# Autodesk Inventor assembly: Main
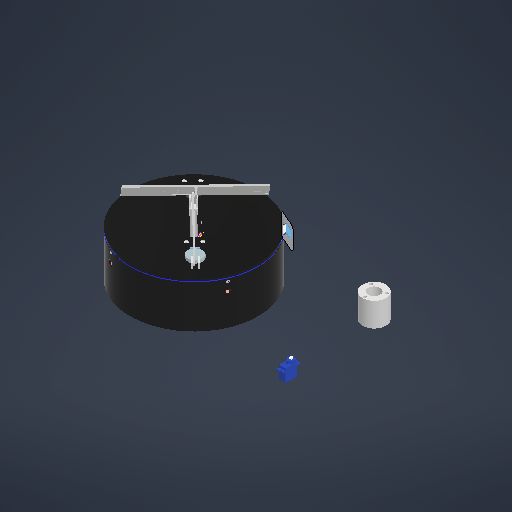
[picture p0: Inventor's stored thumbnail of the model, 512x512]
Saved by Autodesk Inventor 2027.1 (Build 311270010, 270A)
## iProperties
Created: 2026-11-02
Part Number: Main
Document SubType Name: Assembly
Designer: Rozkurwiator
Author: Rozkurwiator
## Documents named in this file (22)
- G:\Github\Suntracker\V2\Hardware\Main.iam
- G:\Github\Suntracker\V2\Hardware\Parts\base.ipt
- G:\Github\Suntracker\V2\Hardware\Parts\LDR\LDR.ipt
- G:\Github\Suntracker\V2\Hardware\Parts\Bearing_ball.ipt
- G:\Github\Suntracker\V2\Hardware\Parts\Cascet.ipt
- G:\Github\Suntracker\V2\Hardware\Parts\gwint_m3\gwint_m3.ipt
- G:\Github\Suntracker\V2\Hardware\Parts\srobka_m3\srobka_m3.ipt
- G:\Github\Suntracker\V2\Hardware\Parts\Slip Ring 12 Wire 22mm.ipt
- G:\Github\Suntracker\V2\Hardware\Parts\top.ipt
- G:\Github\Suntracker\V2\Hardware\Parts\Main_axis.ipt
- G:\Github\Suntracker\V2\Hardware\Parts\Stepper motor  1PC\Stepper motor  1PC.ipt
- G:\Github\Suntracker\V2\Hardware\Parts\9V Solar Cell 125mmx195mm v3\9V Solar Cell 125mmx195mm v3.ipt
- G:\Github\Suntracker\V2\Hardware\Parts\SERVO_SG90\SERVO_SG90.ipt
- G:\Github\Suntracker\V2\Hardware\Parts\sroba_toczna.ipt
- G:\Github\Suntracker\V2\Hardware\Parts\bearing_support.ipt
- G:\Github\Suntracker\V2\Hardware\Parts\10x15x4_bearing\10x15x4_bearing.ipt
- G:\Github\Suntracker\V2\Hardware\Parts\locomotive.ipt
- G:\Github\Suntracker\V2\Hardware\Parts\cuck_link.ipt
- G:\Github\Suntracker\V2\Hardware\Parts\panel_link.ipt
- G:\Github\Suntracker\V2\Hardware\Parts\Shaft_drive.ipt
- G:\Github\Suntracker\V2\Hardware\Parts\gearbox_parts\Przekładnie walcowe.iam
- G:\Github\Suntracker\V2\Hardware\Parts\azimuth_drive.ipt
## Components (105 placed, 21 different names)
1. base:1 — Zestawiające:1, Obrotowe:25, Obrotowe:27, Obrotowe:29, Obrotowe:33, Obrotowe:36
2. Cascet:1 — Obrotowe:29, Obrotowe:30
3. Slip Ring 12 Wire 22mm:1 — Obrotowe:31, Obrotowe:32
4. top:1 — Obrotowe:13, Obrotowe:14, Obrotowe:18, Obrotowe:23, Obrotowe:24, Obrotowe:31, Obrotowe:32, Obrotowe:36, Obrotowe:37
5. Stepper motor  1PC:1 — Obrotowe:21, Obrotowe:22
6. 9V Solar Cell 125mmx195mm v3:1 — Sztywne:1
7. SERVO_SG90:1
8. Main_axis:1
9. sroba_toczna:1 — Obrotowe:16, Walcowe:1, Obrót/przesunięcie:1
10. bearing_support:1 — Obrotowe:13, Obrotowe:14, Obrotowe:17
11. 10x15x4_bearing:1 — Obrotowe:16, Obrotowe:17
12. locomotive:1 — Walcowe:1, Obrotowe:19, Obrót/przesunięcie:1
13. cuck_link:1 — Obrotowe:18, Obrotowe:20
14. panel_link:1 — Obrotowe:19, Obrotowe:20, Sztywne:1
15. Shaft_drive:1 — Obrotowe:21, Obrotowe:22, Obrotowe:23, Obrotowe:24
16. Stepper motor  1PC:2 — Obrotowe:34, Obrotowe:35, Sztywne:2, Obrotowe:37
17. Przekładnie walcowe:1 [sub-assembly] — Obrotowe:33, Sztywne:2
18. azimuth_drive:1 — Obrotowe:34, Obrotowe:35
19. LDR:1 — Obrotowe:25
20. LDR:2
21. LDR:3
22. LDR:4
23. srobka_m3:1 — Obrotowe:5, Obrotowe:27
24. gwint_m3:1 — Obrotowe:5
25. srobka_m3:2
26. gwint_m3:2
27. srobka_m3:3
28. gwint_m3:3
29. srobka_m3:4
30. gwint_m3:4
31. Bearing_ball:1 — Obrotowe:30
32. Bearing_ball:2
33. Bearing_ball:3
34. Bearing_ball:4
35. Bearing_ball:5
36. Bearing_ball:6
37. Bearing_ball:7
38. Bearing_ball:8
39. Bearing_ball:9
40. Bearing_ball:10
41. Bearing_ball:11
42. Bearing_ball:12
43. Bearing_ball:13
44. Bearing_ball:14
45. Bearing_ball:15
46. Bearing_ball:16
47. Bearing_ball:17
48. Bearing_ball:18
49. Bearing_ball:19
50. Bearing_ball:20
51. Bearing_ball:21
52. Bearing_ball:22
53. Bearing_ball:23
54. Bearing_ball:24
55. Bearing_ball:25
56. Bearing_ball:26
57. Bearing_ball:27
58. Bearing_ball:28
59. Bearing_ball:29
60. Bearing_ball:30
61. Bearing_ball:31
62. Bearing_ball:32
63. Bearing_ball:33
64. Bearing_ball:34
65. Bearing_ball:35
66. Bearing_ball:36
67. Bearing_ball:37
68. Bearing_ball:38
69. Bearing_ball:39
70. Bearing_ball:40
71. Bearing_ball:41
72. Bearing_ball:42
73. Bearing_ball:43
74. Bearing_ball:44
75. Bearing_ball:45
76. Bearing_ball:46
77. Bearing_ball:47
78. Bearing_ball:48
79. Bearing_ball:49
80. Bearing_ball:50
81. Bearing_ball:51
82. Bearing_ball:52
83. Bearing_ball:53
84. Bearing_ball:54
85. Bearing_ball:55
86. Bearing_ball:56
87. Bearing_ball:57
88. Bearing_ball:58
89. Bearing_ball:59
90. Bearing_ball:60
91. Bearing_ball:61
92. Bearing_ball:62
93. Bearing_ball:63
94. Bearing_ball:64
95. Bearing_ball:65
96. Bearing_ball:66
97. Bearing_ball:67
98. Bearing_ball:68
99. Bearing_ball:69
100. Bearing_ball:70
101. Bearing_ball:71
102. Bearing_ball:72
103. Bearing_ball:73
104. Bearing_ball:74
105. Bearing_ball:75
## Component patterns: (4 elements, first: LDR:1), (4 elements, first: srobka_m3:1 + gwint_m3:1), (75 elements, first: Bearing_ball:1)
## Relationships (28: RevoluteJoint 23, WeldJoint 2, Mate 1, CylindricalJoint 1, RelateRotateTranslate 1)
- Obrotowe:5 [RevoluteJoint] (2 mm): srobka_m3:1 ↔ gwint_m3:1
- Zestawiające:1 [Mate]: base:1
- Obrotowe:13 [RevoluteJoint]: top:1 ↔ bearing_support:1
- Obrotowe:14 [RevoluteJoint]: top:1 ↔ bearing_support:1
- Obrotowe:16 [RevoluteJoint]: sroba_toczna:1 ↔ 10x15x4_bearing:1
- Obrotowe:17 [RevoluteJoint]: bearing_support:1 ↔ 10x15x4_bearing:1
- Walcowe:1 [CylindricalJoint]: sroba_toczna:1 ↔ locomotive:1
- Obrotowe:18 [RevoluteJoint]: top:1 ↔ cuck_link:1
- Obrotowe:19 [RevoluteJoint]: locomotive:1 ↔ panel_link:1
- Obrotowe:20 [RevoluteJoint] (-0.035 mm): cuck_link:1 ↔ panel_link:1
- Sztywne:1 [WeldJoint]: 9V Solar Cell 125mmx195mm v3:1 ↔ panel_link:1
- Obrotowe:21 [RevoluteJoint]: Stepper motor  1PC:1 ↔ Shaft_drive:1
- Obrotowe:22 [RevoluteJoint]: Stepper motor  1PC:1 ↔ Shaft_drive:1
- Obrotowe:23 [RevoluteJoint]: top:1 ↔ Shaft_drive:1
- Obrotowe:24 [RevoluteJoint]: top:1 ↔ Shaft_drive:1
- Obrót/przesunięcie:1 [RelateRotateTranslate] (31.416 mm): sroba_toczna:1 ↔ locomotive:1
- Obrotowe:25 [RevoluteJoint]: base:1 ↔ LDR:1
- Obrotowe:27 [RevoluteJoint] (-0.1 mm): base:1 ↔ srobka_m3:1
- Obrotowe:29 [RevoluteJoint]: base:1 ↔ Cascet:1
- Obrotowe:30 [RevoluteJoint] (0.3 mm): Cascet:1 ↔ Bearing_ball:1
- Obrotowe:31 [RevoluteJoint]: Slip Ring 12 Wire 22mm:1 ↔ top:1
- Obrotowe:32 [RevoluteJoint]: Slip Ring 12 Wire 22mm:1 ↔ top:1
- Obrotowe:33 [RevoluteJoint] (10 mm): base:1 ↔ Przekładnie walcowe:1
- Obrotowe:34 [RevoluteJoint]: Stepper motor  1PC:2 ↔ azimuth_drive:1
- Obrotowe:35 [RevoluteJoint]: Stepper motor  1PC:2 ↔ azimuth_drive:1
- Sztywne:2 [WeldJoint] (-6 mm): Stepper motor  1PC:2 ↔ Przekładnie walcowe:1
- Obrotowe:36 [RevoluteJoint] (84 mm): base:1 ↔ top:1
- Obrotowe:37 [RevoluteJoint] (-5 mm): top:1 ↔ Stepper motor  1PC:2
## Named parameters: Base_radius = 120 mm, Bearing_ball_radius = 2.5 mm, Base_wall_thickness = 4 mm, Base_floor_thickness = 2 mm, Bearing_balls_count = 75, Cascet_mounting_holes_count = 4, Cascet_mounting_holes_size = 1.5 mm, Cascet_mounting_holes_offset = 5 mm, Photoresistors_height = 60 mm, Photoresistors_count = 4
